# Autodesk Inventor assembly: Ensemble1
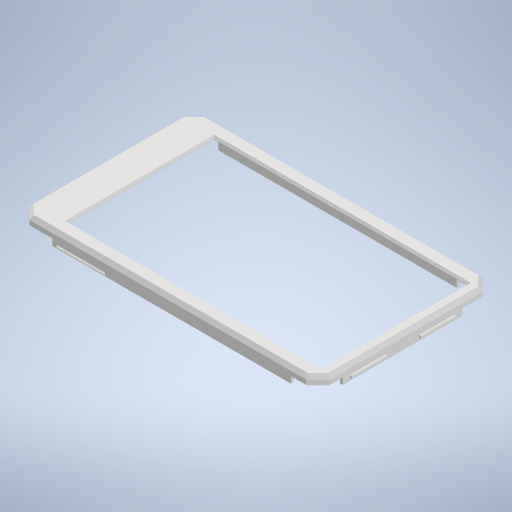
[picture p0: Inventor's stored thumbnail of the model, 512x512]
Saved by Autodesk Inventor 2024 (Build 280153000, 153)
## iProperties
Created: 2026-10-29
Part Number: Ensemble1
Document SubType Name: Assembly
Designer: berno
Author: berno
## Documents named in this file (3)
- A:\bernon\Robotique\Pamk_Phone\Ensemble1.iam
- A:\bernon\Robotique\Pamk_Phone\Pièce1.ipt
- A:\bernon\Robotique\Pamk_Phone\Pièce2.ipt
## Components (2 placed, 2 different names)
1. Pièce1:1 — Affleurement:1, Affleurement:2, Affleurement:3
2. Pièce2:1 — Affleurement:1, Affleurement:2, Affleurement:3
## Relationships (3: Flush 3)
- Affleurement:1 [Flush]: Pièce1:1 ↔ Pièce2:1
- Affleurement:2 [Flush]: Pièce1:1 ↔ Pièce2:1
- Affleurement:3 [Flush]: Pièce1:1 ↔ Pièce2:1
